# Autodesk Inventor assembly: mecanum1
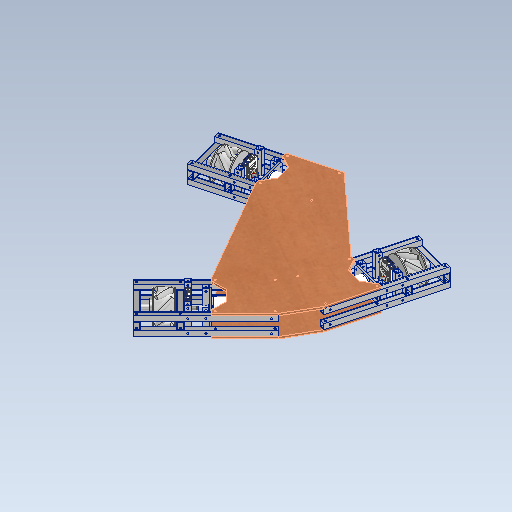
[picture p0: Inventor's stored thumbnail of the model, 512x512]
Saved by Autodesk Inventor 2027.1 (Build 311270010, 270A)
## iProperties
Created: 2026-10-20
Part Number: mecanum1
Document SubType Name: Assembly
Designer: ug_nd
Author: ug_nd
## Documents named in this file (8)
- C:\Users\ug_nd\git_local\3wd_mecanums\cad\mecanum1\mecanum1.iam
- C:\Users\ug_nd\git_local\3wd_mecanums\cad\standard_assy\standard_assy.iam
- C:\Users\ug_nd\git_local\3wd_mecanums\cad\common_parts\mecanumL.iam
- C:\Users\ug_nd\git_local\3wd_mecanums\cad\common_parts\mecanumR.iam
- C:\Users\ug_nd\git_local\3wd_mecanums\cad\mecanum1\wdfs_mcnm1_base.ipt
- C:\Users\ug_nd\git_local\3wd_mecanums\cad\mecanum1\alsp_10_15_82_1.ipt
- C:\Users\ug_nd\git_local\3wd_mecanums\cad\mecanum1\alsp_10_15_42_1.ipt
- C:\Users\ug_nd\git_local\3wd_mecanums\cad\mecanum1\wdfs_mcnm1_top.ipt
## Components (10 placed, 7 different names)
1. standard_assy:1 [sub-assembly] — メイト:1, メイト:2, フラッシュ:2, フラッシュ:3, メイト:10, メイト:24, メイト:28, メイト:31, メイト:32, メイト:34
2. mecanumL:1 [sub-assembly] — メイト:1, メイト:2
3. standard_assy:2 [sub-assembly] — メイト:3, メイト:4, フラッシュ:5, フラッシュ:6, メイト:17, メイト:23
4. mecanumR:1 [sub-assembly] — メイト:3, メイト:4
5. standard_assy:3 [sub-assembly] — メイト:5, メイト:6, フラッシュ:8, フラッシュ:9, メイト:22, メイト:25, メイト:26, メイト:27, メイト:29, メイト:30, メイト:33
6. mecanumR:2 [sub-assembly] — メイト:5, メイト:6
7. wdfs_mcnm1_base:1 — メイト:23, メイト:24, メイト:25
8. alsp_10_15_82_1:1 — メイト:26, メイト:27, メイト:28
9. alsp_10_15_42_1:1 — メイト:29, メイト:30, メイト:31
10. wdfs_mcnm1_top:1 — メイト:32, メイト:33, メイト:34
## Relationships (50: Mate 34, Flush 9, Angle 7)
- メイト:1 [Mate]: standard_assy:1 ↔ mecanumL:1
- メイト:2 [Mate]: standard_assy:1 ↔ mecanumL:1
- メイト:3 [Mate]: standard_assy:2 ↔ mecanumR:1
- メイト:4 [Mate]: standard_assy:2 ↔ mecanumR:1
- メイト:5 [Mate]: standard_assy:3 ↔ mecanumR:2
- メイト:6 [Mate]: standard_assy:3 ↔ mecanumR:2
- フラッシュ:1 [Flush] (200 mm)
- メイト:7 [Mate]
- メイト:8 [Mate]
- メイト:9 [Mate]
- 角度:1 [Angle] (45 deg)
- フラッシュ:2 [Flush]: standard_assy:1
- フラッシュ:3 [Flush] (-30 mm): standard_assy:1
- メイト:10 [Mate] (17.5 mm): standard_assy:1
- メイト:11 [Mate]
- 角度:2 [Angle] (-120 deg)
- メイト:12 [Mate]
- 角度:3 [Angle] (120 deg)
- メイト:13 [Mate]
- 角度:4 [Angle] (150 deg)
- フラッシュ:4 [Flush] (200 mm)
- メイト:14 [Mate]
- メイト:15 [Mate]
- メイト:16 [Mate]
- 角度:5 [Angle] (45 deg)
- フラッシュ:5 [Flush]: standard_assy:2
- フラッシュ:6 [Flush] (-30 mm): standard_assy:2
- メイト:17 [Mate] (17.5 mm): standard_assy:2
- メイト:18 [Mate]
- 角度:6 [Angle] (30 deg)
- フラッシュ:7 [Flush] (200 mm)
- メイト:19 [Mate]
- メイト:20 [Mate]
- メイト:21 [Mate]
- 角度:7 [Angle] (45 deg)
- フラッシュ:8 [Flush]: standard_assy:3
- フラッシュ:9 [Flush] (-30 mm): standard_assy:3
- メイト:22 [Mate] (17.5 mm): standard_assy:3
- メイト:23 [Mate]: standard_assy:2 ↔ wdfs_mcnm1_base:1
- メイト:24 [Mate]: standard_assy:1 ↔ wdfs_mcnm1_base:1
- メイト:25 [Mate]: standard_assy:3 ↔ wdfs_mcnm1_base:1
- メイト:26 [Mate]: standard_assy:3 ↔ alsp_10_15_82_1:1
- メイト:27 [Mate]: standard_assy:3 ↔ alsp_10_15_82_1:1
- メイト:28 [Mate]: standard_assy:1 ↔ alsp_10_15_82_1:1
- メイト:29 [Mate]: standard_assy:3 ↔ alsp_10_15_42_1:1
- メイト:30 [Mate]: standard_assy:3 ↔ alsp_10_15_42_1:1
- メイト:31 [Mate]: standard_assy:1 ↔ alsp_10_15_42_1:1
- メイト:32 [Mate]: standard_assy:1 ↔ wdfs_mcnm1_top:1
- メイト:33 [Mate]: standard_assy:3 ↔ wdfs_mcnm1_top:1
- メイト:34 [Mate]: standard_assy:1 ↔ wdfs_mcnm1_top:1
